# Autodesk Inventor assembly: Assembly1
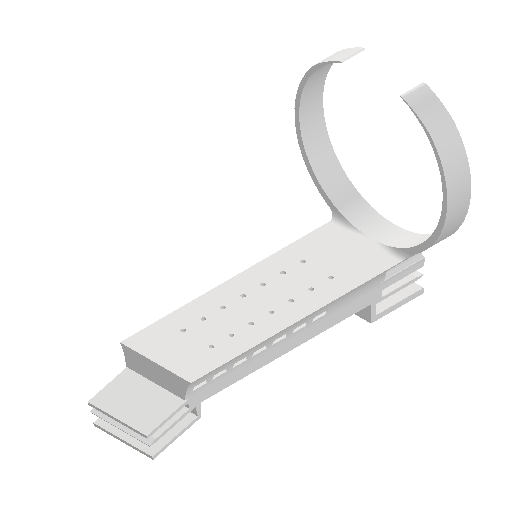
[picture p0: Inventor's stored thumbnail of the model, 512x512]
Saved by Autodesk Inventor 2026 (Build 300175050, 175E)
## iProperties
Created: 2026-11-25
Part Number: Assembly1
Document SubType Name: Assembly
Designer: David Zindović
Author: David Zindović
## Documents named in this file (3)
- C:\Users\David Zindović\Desktop\Projekti\Darila\Nika_stojalo_za_UV_luc\Assembly1.iam
- C:\Users\David Zindović\Desktop\Projekti\Darila\Nika_stojalo_za_UV_luc\TOP.ipt
- C:\Users\David Zindović\Desktop\Projekti\Darila\Nika_stojalo_za_UV_luc\Bottom.ipt
## Components (2 placed, 2 different names)
1. TOP:1 — Mate:1, Mate:4
2. Bottom:1 — Mate:1, Mate:4
## Relationships (2: Mate 2)
- Mate:1: TOP:1 ↔ Bottom:1
- Mate:4: TOP:1 ↔ Bottom:1
